# Autodesk Inventor assembly: EDFAsembly
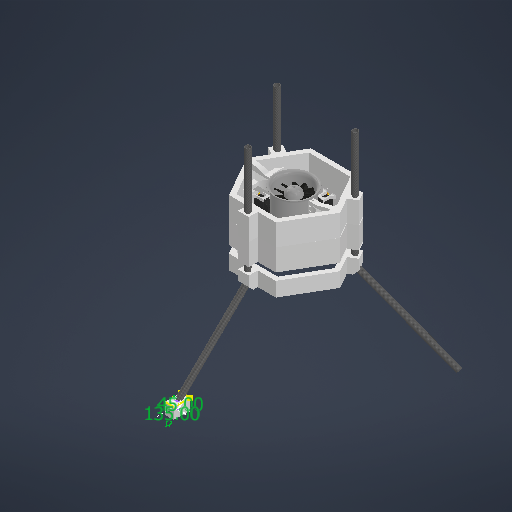
[picture p0: Inventor's stored thumbnail of the model, 512x512]
Saved by Autodesk Inventor 2026.3 (Build 303398000, 398)
## iProperties
Created: 2026-06-26
Part Number: EDFAsembly
Document SubType Name: Assembly
Designer: joaqu
Author: joaqu
## Documents named in this file (9)
- C:\Users\joaqu\OneDrive\Documents\Current V1 (EDF Hopper)\mg995\EDFAsembly.iam
- C:\Users\joaqu\OneDrive\Documents\Current V1 (EDF Hopper)\Gear Base.ipt
- C:\Users\joaqu\OneDrive\Documents\Current V1 (EDF Hopper)\5287T617_High-Strength Lightweight Carbon Fiber Tube\5287T617_High-Strength Lightweight Carbon Fiber Tube.ipt
- C:\Users\joaqu\OneDrive\Documents\Current V1 (EDF Hopper)\mg995\mg995.ipt
- C:\Users\joaqu\OneDrive\Documents\Current V1 (EDF Hopper)\90mm-edf\90mm-edf.ipt
- C:\Users\joaqu\OneDrive\Documents\Current V1 (EDF Hopper)\Thrust Ring.ipt
- C:\Users\joaqu\OneDrive\Documents\Current V1 (EDF Hopper)\Control RingV1.ipt
- C:\Users\joaqu\OneDrive\Documents\Current V1 (EDF Hopper)\Vane 2.0.ipt
- C:\Users\joaqu\OneDrive\Documents\Current V1 (EDF Hopper)\Feet.ipt
## Components (16 placed, 8 different names)
1. Gear Base:1 — Mate:1, Rotational:1, Mate:2, Rotational:2, Mate:4
2. Control RingV1:1 — Mate:3, Mate:4, Cylindrical:1, Mate:5, Mate:6, Mate:7, Mate:8, Mate:9, Mate:10, Mate:11, Mate:12, Mate:13, Mate:14, Mate:15, Mate:16
3. mg995:1 — Mate:5, Mate:6, Mate:7
4. mg995:2 — Mate:8, Mate:9, Mate:10, Mate:11
5. mg995:3 — Mate:12, Mate:13, Mate:14, Mate:20
6. mg995:4 — Mate:15, Mate:16
7. Thrust Ring:1 — Mate:17, Mate:18, Mate:19
8. 90mm-edf:1 — Mate:19
9. Vane 2.0:1 — Mate:20
10. Feet:1 — Mate:21
11. 5287T617_High-Strength Lightweight Carbon Fiber Tube:1 — Mate:1, Rotational:1, Mate:21
12. 5287T617_High-Strength Lightweight Carbon Fiber Tube:2
13. 5287T617_High-Strength Lightweight Carbon Fiber Tube:3
14. 5287T617_High-Strength Lightweight Carbon Fiber Tube:4 — Mate:2, Rotational:2, Mate:3, Cylindrical:1, Mate:17
15. 5287T617_High-Strength Lightweight Carbon Fiber Tube:5 — Mate:18
16. 5287T617_High-Strength Lightweight Carbon Fiber Tube:6
## Component patterns: (3 elements, first: 5287T617_High-Strength Lightweight Carbon Fiber Tube:1), (3 elements, first: 5287T617_High-Strength Lightweight Carbon Fiber Tube:4)
## Relationships (24: Mate 21, RevoluteJoint 2, CylindricalJoint 1)
- Mate:1: Gear Base:1 ↔ 5287T617_High-Strength Lightweight Carbon Fiber Tube:1
- Rotational:1 [RevoluteJoint]: Gear Base:1 ↔ 5287T617_High-Strength Lightweight Carbon Fiber Tube:1
- Mate:2: Gear Base:1 ↔ 5287T617_High-Strength Lightweight Carbon Fiber Tube:4
- Rotational:2 [RevoluteJoint]: Gear Base:1 ↔ 5287T617_High-Strength Lightweight Carbon Fiber Tube:4
- Mate:3: Control RingV1:1 ↔ 5287T617_High-Strength Lightweight Carbon Fiber Tube:4
- Mate:4 (20 mm): Gear Base:1 ↔ Control RingV1:1
- Cylindrical:1: Control RingV1:1 ↔ 5287T617_High-Strength Lightweight Carbon Fiber Tube:4
- Mate:5: Control RingV1:1 ↔ mg995:1
- Mate:6: Control RingV1:1 ↔ mg995:1
- Mate:7: Control RingV1:1 ↔ mg995:1
- Mate:8: Control RingV1:1 ↔ mg995:2
- Mate:9: Control RingV1:1 ↔ mg995:2
- Mate:10: Control RingV1:1 ↔ mg995:2
- Mate:11: Control RingV1:1 ↔ mg995:2
- Mate:12: Control RingV1:1 ↔ mg995:3
- Mate:13: Control RingV1:1 ↔ mg995:3
- Mate:14: Control RingV1:1 ↔ mg995:3
- Mate:15: Control RingV1:1 ↔ mg995:4
- Mate:16: Control RingV1:1 ↔ mg995:4
- Mate:17: Thrust Ring:1 ↔ 5287T617_High-Strength Lightweight Carbon Fiber Tube:4
- Mate:18: Thrust Ring:1 ↔ 5287T617_High-Strength Lightweight Carbon Fiber Tube:5
- Mate:19: Thrust Ring:1 ↔ 90mm-edf:1
- Mate:20: mg995:3 ↔ Vane 2.0:1
- Mate:21: Feet:1 ↔ 5287T617_High-Strength Lightweight Carbon Fiber Tube:1
